# Autodesk Inventor assembly: INTK_000_assembley
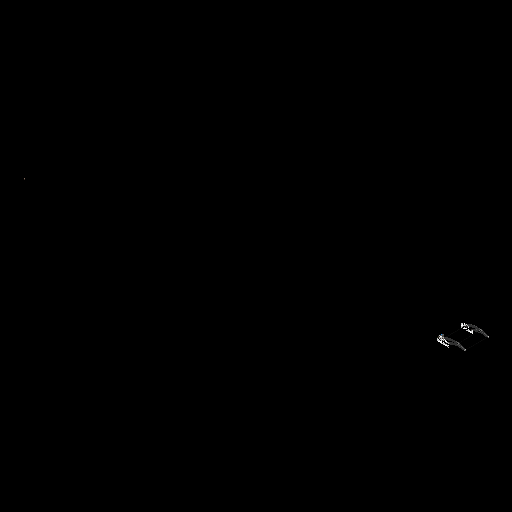
[picture p0: Inventor's stored thumbnail of the model, 512x512]
Saved by Autodesk Inventor 2027.1 (Build 311270010, 270A)
## iProperties
Created: 2026-11-21
Part Number: INTK_000_assembley
Document SubType Name: Assembly
Designer: Stanley Ruangsuwan
Author: Stanley Ruangsuwan
## Documents named in this file (16)
- C:\Users\stanr\Documents\GitHub\2026-2027-DesignTraining\Stan\intake exersize\INTK_000_assembley.iam
- C:\Users\stanr\Documents\GitHub\2026-2027-DesignTraining\Stan\intake exersize\INTK_002_left bar.ipt
- C:\Users\stanr\Documents\GitHub\2026-2027-DesignTraining\Stan\intake exersize\INTK_004_top bar.ipt
- C:\Users\stanr\Documents\GitHub\2026-2027-DesignTraining\Stan\intake exersize\INTK_005_Right bar.ipt
- C:\Users\stanr\Documents\GitHub\2026-2027-DesignTraining\COTS Library\Motion\Bearings\COTS_WCP-0783_1.125ODHexBearing.ipt
- C:\Users\stanr\Documents\GitHub\2026-2027-DesignTraining\COTS Library\Motors\COTS_WCP-0940_KrakenX60_New.ipt
- C:\Users\stanr\Documents\GitHub\2026-2027-DesignTraining\COTS Library\Motion\Gears\20DP gears\Aluminum\COTS_WCP-0707_32T_0.5inHex.ipt
- C:\Users\stanr\Documents\GitHub\2026-2027-DesignTraining\COTS Library\Motion\Gears\20DP gears\Aluminum\COTS_WCP-0701_20T_0.5inHex.ipt
- C:\Users\stanr\Documents\GitHub\2026-2027-DesignTraining\COTS Library\Motion\Gears\20DP gears\Aluminum\COTS_WCP-0702_22T_0.5inHex.ipt
- C:\Users\stanr\Documents\GitHub\2026-2027-DesignTraining\COTS Library\Adapters\COTS_WCP-1118_8mmSpline-.5inHexAdaptor.ipt
- C:\Users\stanr\Documents\GitHub\2026-2027-DesignTraining\Stan\intake exersize\churro 1.1in.ipt
- C:\Users\stanr\Downloads\WCP-1143\WCP-1143.ipt
- C:\Users\stanr\Documents\GitHub\2026-2027-DesignTraining\COTS Library\Fasteners\Bolts\Socket-Head\10-32\COTS_91251A352_1.5in Long_Black-Oxide Alloy Steel Socket Head.ipt
- C:\Users\stanr\Documents\GitHub\2026-2027-DesignTraining\Stan\intake exersize\INTK_006_kraken holder pocketed\INTK_006_kraken holder pocketed.ipt
- C:\Users\stanr\Documents\GitHub\2026-2027-DesignTraining\Stan\intake exersize\INTK_003_bar holder thingy pocketed\INTK_003_bar holder thingy pocketed.ipt
- C:\Users\stanr\Documents\GitHub\2026-2027-DesignTraining\Stan\intake exersize\INTK_007_long ahh hex.ipt
## Components (37 placed, 15 different names)
1. INTK_002_left bar:1 — Mate:1, Mate:4, Mate:7, Mate:10, Mate:14, Mate:37, Mate:38, Mate:39
2. INTK_004_top bar:1 — Mate:1, Mate:2, Mate:3, Mate:5, Mate:11, Mate:15
3. INTK_005_Right bar:1 — Mate:2, Mate:6, Mate:8, Mate:9, Mate:12, Mate:13
4. COTS_WCP-0783_1.125ODHexBearing:1 — Mate:5, Mate:15, Mate:24
5. COTS_WCP-0783_1.125ODHexBearing:2 — Mate:3, Mate:11, Mate:23
6. COTS_WCP-0783_1.125ODHexBearing:3 — Mate:6, Mate:12, Mate:24, Mate:91
7. COTS_WCP-0783_1.125ODHexBearing:4 — Mate:4, Mate:14, Mate:23, Flush:9
8. COTS_WCP-0783_1.125ODHexBearing:5 — Mate:8, Mate:9, Mate:13, Mate:62
9. COTS_WCP-0783_1.125ODHexBearing:6 — Mate:7, Mate:10, Mate:61
10. COTS_WCP-0783_1.125ODHexBearing:7 — Mate:29, Mate:51
11. COTS_WCP-0707_32T_0.5inHex:1 — Flush:2
12. COTS_WCP-0701_20T_0.5inHex:2 — Mate:29, Flush:1
13. COTS_WCP-0702_22T_0.5inHex:2 — Flush:1, Flush:4, Mate:42
14. COTS_WCP-1118_8mmSpline-.5inHexAdaptor:1 — Flush:2
15. COTS_WCP-0783_1.125ODHexBearing:8 — Mate:42, Mate:59, Mate:60
16. churro 1.1in:1 — Mate:54, Mate:58, Mate:96, Mate:97
17. WCP-1143:1 — Mate:37, Mate:38, Mate:39, Flush:4, Mate:63
18. churro 1.1in:4
19. COTS_91251A352_1.5in Long_Black-Oxide Alloy Steel Socket Head:2 — Mate:47, Mate:55, Mate:90
20. COTS_91251A352_1.5in Long_Black-Oxide Alloy Steel Socket Head:3 — Mate:49, Mate:53, Mate:94
21. COTS_91251A352_1.5in Long_Black-Oxide Alloy Steel Socket Head:4 — Mate:48, Mate:56, Mate:57
22. INTK_006_kraken holder pocketed:1 — Mate:47, Mate:48, Mate:49, Mate:59, Mate:60, Mate:89, Mate:95, Mate:96
23. INTK_003_bar holder thingy pocketed:1 — Mate:51, Mate:53, Mate:54, Mate:55, Mate:56, Mate:57, Mate:58, Mate:61, Mate:62, Mate:64, Flush:6, Mate:90, Mate:97
24. INTK_007_long ahh hex:1 — Mate:63, Mate:64, Mate:87, Mate:88
25. INTK_003_bar holder thingy pocketed:2 — Mate:85, Mate:86, Flush:6, Mate:88
26. INTK_002_left bar:2
27. INTK_004_top bar:2
28. INTK_005_Right bar:2
29. COTS_WCP-0783_1.125ODHexBearing:10 — Flush:8
30. COTS_WCP-0783_1.125ODHexBearing:11 — Mate:93, Flush:7
31. COTS_WCP-0783_1.125ODHexBearing:12 — Mate:92
32. COTS_WCP-0783_1.125ODHexBearing:13
33. COTS_WCP-0783_1.125ODHexBearing:14 — Mate:86
34. COTS_WCP-0783_1.125ODHexBearing:15 — Mate:85, Mate:87
35. COTS_WCP-0940_KrakenX60_New:2 — Mate:89, Mate:94, Mate:95
36. INTK_007_long ahh hex:2 — Mate:91, Mate:92, Flush:8
37. INTK_007_long ahh hex:3 — Mate:93, Flush:7, Flush:9
## Relationships (75: Mate 68, Flush 7)
- Mate:1: INTK_002_left bar:1 ↔ INTK_004_top bar:1
- Mate:2: INTK_004_top bar:1 ↔ INTK_005_Right bar:1
- Mate:3: INTK_004_top bar:1 ↔ COTS_WCP-0783_1.125ODHexBearing:2
- Mate:4: INTK_002_left bar:1 ↔ COTS_WCP-0783_1.125ODHexBearing:4
- Mate:5: INTK_004_top bar:1 ↔ COTS_WCP-0783_1.125ODHexBearing:1
- Mate:6: INTK_005_Right bar:1 ↔ COTS_WCP-0783_1.125ODHexBearing:3
- Mate:7: INTK_002_left bar:1 ↔ COTS_WCP-0783_1.125ODHexBearing:6
- Mate:8: INTK_005_Right bar:1 ↔ COTS_WCP-0783_1.125ODHexBearing:5
- Mate:9: INTK_005_Right bar:1 ↔ COTS_WCP-0783_1.125ODHexBearing:5
- Mate:10: INTK_002_left bar:1 ↔ COTS_WCP-0783_1.125ODHexBearing:6
- Mate:11: INTK_004_top bar:1 ↔ COTS_WCP-0783_1.125ODHexBearing:2
- Mate:12: INTK_005_Right bar:1 ↔ COTS_WCP-0783_1.125ODHexBearing:3
- Mate:13: INTK_005_Right bar:1 ↔ COTS_WCP-0783_1.125ODHexBearing:5
- Mate:14: INTK_002_left bar:1 ↔ COTS_WCP-0783_1.125ODHexBearing:4
- Mate:15: INTK_004_top bar:1 ↔ COTS_WCP-0783_1.125ODHexBearing:1
- Mate:23: COTS_WCP-0783_1.125ODHexBearing:2 ↔ COTS_WCP-0783_1.125ODHexBearing:4
- Mate:24: COTS_WCP-0783_1.125ODHexBearing:1 ↔ COTS_WCP-0783_1.125ODHexBearing:3
- Mate:29: COTS_WCP-0783_1.125ODHexBearing:7 ↔ COTS_WCP-0701_20T_0.5inHex:2
- Flush:1: COTS_WCP-0701_20T_0.5inHex:2 ↔ COTS_WCP-0702_22T_0.5inHex:2
- Flush:2: COTS_WCP-0707_32T_0.5inHex:1 ↔ COTS_WCP-1118_8mmSpline-.5inHexAdaptor:1
- Mate:37: INTK_002_left bar:1 ↔ WCP-1143:1
- Mate:38: INTK_002_left bar:1 ↔ WCP-1143:1
- Mate:39: INTK_002_left bar:1 ↔ WCP-1143:1
- Flush:4: COTS_WCP-0702_22T_0.5inHex:2 ↔ WCP-1143:1
- Mate:42: COTS_WCP-0702_22T_0.5inHex:2 ↔ COTS_WCP-0783_1.125ODHexBearing:8
- Mate:47: COTS_91251A352_1.5in Long_Black-Oxide Alloy Steel Socket Head:2 ↔ INTK_006_kraken holder pocketed:1
- Mate:48: COTS_91251A352_1.5in Long_Black-Oxide Alloy Steel Socket Head:4 ↔ INTK_006_kraken holder pocketed:1
- Mate:49: COTS_91251A352_1.5in Long_Black-Oxide Alloy Steel Socket Head:3 ↔ INTK_006_kraken holder pocketed:1
- Mate:51: COTS_WCP-0783_1.125ODHexBearing:7 ↔ INTK_003_bar holder thingy pocketed:1
- Mate:53: COTS_91251A352_1.5in Long_Black-Oxide Alloy Steel Socket Head:3 ↔ INTK_003_bar holder thingy pocketed:1
- Mate:54: churro 1.1in:1 ↔ INTK_003_bar holder thingy pocketed:1
- Mate:55: COTS_91251A352_1.5in Long_Black-Oxide Alloy Steel Socket Head:2 ↔ INTK_003_bar holder thingy pocketed:1
- Mate:56: COTS_91251A352_1.5in Long_Black-Oxide Alloy Steel Socket Head:4 ↔ INTK_003_bar holder thingy pocketed:1
- Mate:57: COTS_91251A352_1.5in Long_Black-Oxide Alloy Steel Socket Head:4 ↔ INTK_003_bar holder thingy pocketed:1
- Mate:58: churro 1.1in:1 ↔ INTK_003_bar holder thingy pocketed:1
- Mate:59: COTS_WCP-0783_1.125ODHexBearing:8 ↔ INTK_006_kraken holder pocketed:1
- Mate:60: COTS_WCP-0783_1.125ODHexBearing:8 ↔ INTK_006_kraken holder pocketed:1
- Mate:61: COTS_WCP-0783_1.125ODHexBearing:6 ↔ INTK_003_bar holder thingy pocketed:1
- Mate:62: COTS_WCP-0783_1.125ODHexBearing:5 ↔ INTK_003_bar holder thingy pocketed:1
- Mate:63: WCP-1143:1 ↔ INTK_007_long ahh hex:1
- Mate:64: INTK_003_bar holder thingy pocketed:1 ↔ INTK_007_long ahh hex:1
- [Mate]: INTK_002_left bar:2 ↔ INTK_004_top bar:2
- [Mate]: INTK_004_top bar:2 ↔ INTK_005_Right bar:2
- [Mate]: INTK_004_top bar:2 ↔ COTS_WCP-0783_1.125ODHexBearing:11
- [Mate]: INTK_002_left bar:2 ↔ COTS_WCP-0783_1.125ODHexBearing:13
- [Mate]: INTK_004_top bar:2 ↔ COTS_WCP-0783_1.125ODHexBearing:10
- [Mate]: INTK_005_Right bar:2 ↔ COTS_WCP-0783_1.125ODHexBearing:12
- [Mate]: INTK_002_left bar:2 ↔ COTS_WCP-0783_1.125ODHexBearing:15
- [Mate]: INTK_005_Right bar:2 ↔ COTS_WCP-0783_1.125ODHexBearing:14
- [Mate]: INTK_005_Right bar:2 ↔ COTS_WCP-0783_1.125ODHexBearing:14
- [Mate]: INTK_002_left bar:2 ↔ COTS_WCP-0783_1.125ODHexBearing:15
- [Mate]: INTK_004_top bar:2 ↔ COTS_WCP-0783_1.125ODHexBearing:11
- [Mate]: INTK_005_Right bar:2 ↔ COTS_WCP-0783_1.125ODHexBearing:12
- [Mate]: INTK_005_Right bar:2 ↔ COTS_WCP-0783_1.125ODHexBearing:14
- [Mate]: INTK_002_left bar:2 ↔ COTS_WCP-0783_1.125ODHexBearing:13
- [Mate]: INTK_004_top bar:2 ↔ COTS_WCP-0783_1.125ODHexBearing:10
- [Mate]: COTS_WCP-0783_1.125ODHexBearing:11 ↔ COTS_WCP-0783_1.125ODHexBearing:13
- [Mate]: COTS_WCP-0783_1.125ODHexBearing:10 ↔ COTS_WCP-0783_1.125ODHexBearing:12
- Mate:85: INTK_003_bar holder thingy pocketed:2 ↔ COTS_WCP-0783_1.125ODHexBearing:15
- Mate:86: INTK_003_bar holder thingy pocketed:2 ↔ COTS_WCP-0783_1.125ODHexBearing:14
- Flush:6: INTK_003_bar holder thingy pocketed:1 ↔ INTK_003_bar holder thingy pocketed:2
- Mate:87: INTK_007_long ahh hex:1 ↔ COTS_WCP-0783_1.125ODHexBearing:15
- Mate:88: INTK_007_long ahh hex:1 ↔ INTK_003_bar holder thingy pocketed:2
- Mate:89: INTK_006_kraken holder pocketed:1 ↔ COTS_WCP-0940_KrakenX60_New:2
- Mate:90: COTS_91251A352_1.5in Long_Black-Oxide Alloy Steel Socket Head:2 ↔ INTK_003_bar holder thingy pocketed:1
- Mate:91: COTS_WCP-0783_1.125ODHexBearing:3 ↔ INTK_007_long ahh hex:2
- Mate:92: COTS_WCP-0783_1.125ODHexBearing:12 ↔ INTK_007_long ahh hex:2
- Mate:93: COTS_WCP-0783_1.125ODHexBearing:11 ↔ INTK_007_long ahh hex:3
- Flush:7: COTS_WCP-0783_1.125ODHexBearing:11 ↔ INTK_007_long ahh hex:3
- Flush:8: COTS_WCP-0783_1.125ODHexBearing:10 ↔ INTK_007_long ahh hex:2
- Flush:9: COTS_WCP-0783_1.125ODHexBearing:4 ↔ INTK_007_long ahh hex:3
- Mate:94: COTS_91251A352_1.5in Long_Black-Oxide Alloy Steel Socket Head:3 ↔ COTS_WCP-0940_KrakenX60_New:2
- Mate:95: INTK_006_kraken holder pocketed:1 ↔ COTS_WCP-0940_KrakenX60_New:2
- Mate:96: churro 1.1in:1 ↔ INTK_006_kraken holder pocketed:1
- Mate:97: churro 1.1in:1 ↔ INTK_003_bar holder thingy pocketed:1
## Named parameters: d101_d32 = 0 mm, d102_d33 = 0 mm, d103_d2 = 0 mm, d104_d3 = 0 mm, d105_d4 = 0 mm, d106_d5 = 0 mm, d107_d6 = 0 mm, d108_d7 = 0 mm, d109_d8 = 0 mm, d110_d9 = 0 mm, d111_d10 = 0 mm, d112_d11 = 0 mm, d113_d12 = 0 mm, d114_d13 = 0 mm, d115_d14 = 0 mm, d116_d0 = 0 mm, d117_d1 = 0 mm
